# Autodesk Inventor assembly: VALVULA DE ESFERA 3-4'' INOX
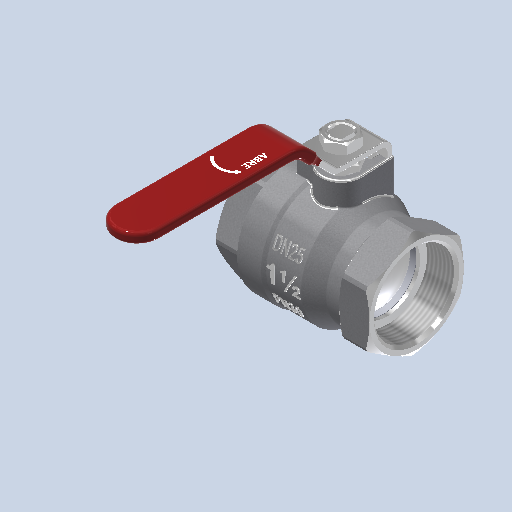
[picture p0: Inventor's stored thumbnail of the model, 512x512]
Saved by Autodesk Inventor 2022.2 (Build 262287010, 287A)
## iProperties
Created: 2017-09-12
Part Number: VALVULA DE ESFERA 3-4'' INOX
Document SubType Name: Assembly
Designer: CESAR
Mass: 1158.23 g
Surface Area: 565.562 cm^2
Volume: 144.779 cm^3
Density: 8 g/cm^3
Author: CESAR
## Documents named in this file (3)
- \\server\projetos\BERTOLLO\ALMOXARIFADO\Content Center Files\PECAS BERTOLLO\AQUECIMENTO\VALVULA DE ESFERA 1.1-2'' INOX\VALVULA DE ESFERA 1.1-2'' INOX.iam
- \\server\projetos\BERTOLLO\ALMOXARIFADO\Content Center Files\PECAS BERTOLLO\AQUECIMENTO\VALVULA DE ESFERA 1.1-2'' INOX\CORPO 1.1-2''.ipt
- \\server\projetos\BERTOLLO\ALMOXARIFADO\Content Center Files\PECAS BERTOLLO\AQUECIMENTO\VALVULA DE ESFERA 1.1-2'' INOX\ALAVANCA 1.1-2''.ipt
## Components (2 placed, 2 different names)
1. CORPO 1.1-2'':1 — Rotativa:1
2. ALAVANCA 1.1-2'':1 — Rotativa:1
## Relationships (1: RevoluteJoint 1)
- Rotativa:1 [RevoluteJoint] (-1.5 mm): CORPO 1.1-2'':1 ↔ ALAVANCA 1.1-2'':1
